# Autodesk Inventor assembly: Assey_Motors
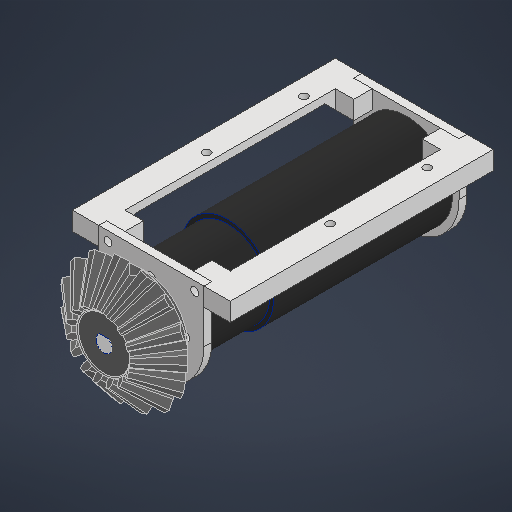
[picture p0: Inventor's stored thumbnail of the model, 512x512]
Saved by Autodesk Inventor 2027.1 (Build 311270010, 270A)
## iProperties
Created: 2026-11-11
Part Number: Assey_Motors
Document SubType Name: Assembly
Designer: takuya
Author: takuya
## Documents named in this file (7)
- D:\model\D2_Conveyor_2026\power_module\Paradox Planetary Gear Reducer\Assey_Motors.iam
- D:\model\D2_Conveyor_2026\power_module\Paradox Planetary Gear Reducer\motor.ipt
- D:\model\D2_Conveyor_2026\power_module\Paradox Planetary Gear Reducer\Gears\M3_15_crown_in.ipt
- D:\model\D2_Conveyor_2026\power_module\Paradox Planetary Gear Reducer\Moter_Fix_Front.ipt
- D:\model\D2_Conveyor_2026\power_module\Paradox Planetary Gear Reducer\Moter_Fix_Back.ipt
- D:\model\D2_Conveyor_2026\power_module\Paradox Planetary Gear Reducer\Moter_Fix_Side.ipt
- D:\model\D2_Conveyor_2026\power_module\Paradox Planetary Gear Reducer\Moter_Fix_Side_MIR1.ipt
## Components (7 placed, 6 different names)
1. motor:1 — メイト:1, フラッシュ:1, 角度:1, メイト:8, メイト:9, フラッシュ:2, フラッシュ:4, 回転:1, メイト:14
2. M3_15_crown_in:1 — メイト:1, フラッシュ:1, 角度:1, メイト:2, メイト:3, メイト:4, メイト:5
3. Moter_Fix_Front:1 — フラッシュ:2, メイト:12, フラッシュ:5, フラッシュ:6, フラッシュ:7, フラッシュ:8, メイト:13
4. Moter_Fix_Back:1 — フラッシュ:4
5. Moter_Fix_Side:1 — メイト:12, フラッシュ:5, フラッシュ:6
6. Moter_Fix_Side_MIR1:1 — フラッシュ:7, フラッシュ:8, メイト:13
7. M3_15_crown_in:2 — 回転:1, メイト:14
## Relationships (23: Mate 14, Flush 7, Angle 1, RevoluteJoint 1)
- メイト:1 [Mate]: motor:1 ↔ M3_15_crown_in:1
- フラッシュ:1 [Flush]: motor:1 ↔ M3_15_crown_in:1
- 角度:1 [Angle] (0 deg): motor:1 ↔ M3_15_crown_in:1
- メイト:2 [Mate]: M3_15_crown_in:1
- メイト:3 [Mate]: M3_15_crown_in:1
- メイト:4 [Mate]: M3_15_crown_in:1
- メイト:5 [Mate]: M3_15_crown_in:1
- メイト:6 [Mate]
- メイト:7 [Mate]
- メイト:8 [Mate]: motor:1
- メイト:9 [Mate]: motor:1
- メイト:10 [Mate]
- メイト:11 [Mate]
- フラッシュ:2 [Flush]: motor:1 ↔ Moter_Fix_Front:1
- フラッシュ:4 [Flush]: motor:1 ↔ Moter_Fix_Back:1
- メイト:12 [Mate]: Moter_Fix_Front:1 ↔ Moter_Fix_Side:1
- フラッシュ:5 [Flush]: Moter_Fix_Front:1 ↔ Moter_Fix_Side:1
- フラッシュ:6 [Flush]: Moter_Fix_Front:1 ↔ Moter_Fix_Side:1
- フラッシュ:7 [Flush]: Moter_Fix_Front:1 ↔ Moter_Fix_Side_MIR1:1
- フラッシュ:8 [Flush]: Moter_Fix_Front:1 ↔ Moter_Fix_Side_MIR1:1
- メイト:13 [Mate]: Moter_Fix_Front:1 ↔ Moter_Fix_Side_MIR1:1
- 回転:1 [RevoluteJoint]: motor:1 ↔ M3_15_crown_in:2
- メイト:14 [Mate]: motor:1 ↔ M3_15_crown_in:2
